# Autodesk Inventor assembly: 2020 Profile Pivot Joint
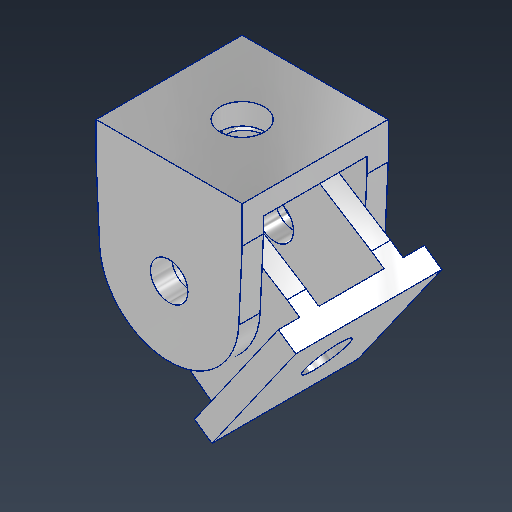
[picture p0: Inventor's stored thumbnail of the model, 512x512]
Saved by Autodesk Inventor 2026.2 (Build 302298010, 298A)
## iProperties
Created: 2026-05-13
Part Number: 2020 Profile Pivot Joint
Document SubType Name: Assembly
Designer: khw
Mass: 15.7543 g
Surface Area: 52.8246 cm^2
Volume: 5.83492 cm^3
Density: 2.7 g/cm^3
Author: khw
## iProperties of the stored document MemberDocs/xAaaaqacaAaaaaaaaAaaaqi21Wa
Created: 2026-05-13
Part Number: 2020 Profile Pivot Joint
Document SubType Name: Assembly
Designer: khw
Mass: 15.7543 g
Surface Area: 52.8246 cm^2
Volume: 5.83492 cm^3
Density: 2.7 g/cm^3
Author: khw
## Documents named in this file (4)
- C:\Users\khw\Desktop\ARD_v1\ARD_hardware\Common Objects\Profile\2020 Profile Pivot Joint\2020 Profile Pivot Joint.iam
- C:\Users\khw\Desktop\ARD_v1\ARD_hardware\Common Objects\Profile\2020 Profile Pivot Joint\Cylinder fixing parts_B parts.ipt
- C:\Users\khw\Desktop\ARD_v1\ARD_hardware\Common Objects\Profile\2020 Profile Pivot Joint\Cylinder fixing parts_A parts.ipt
- C:\Users\khw\Desktop\ARD_v1\ARD_hardware\Common Objects\Profile\2020 Profile Pivot Joint\2020 Profile Pivot Joint_하위.ipt
## Components (2 placed, 2 different names)
1. Cylinder fixing parts_B parts:1 — 메이트:1, 플러쉬:1, 각도:1
2. Cylinder fixing parts_A parts:1 — 메이트:1, 플러쉬:1, 각도:1
## Relationships (3: Mate 1, Flush 1, Angle 1)
- 메이트:1 [Mate]: Cylinder fixing parts_B parts:1 ↔ Cylinder fixing parts_A parts:1
- 플러쉬:1 [Flush]: Cylinder fixing parts_B parts:1 ↔ Cylinder fixing parts_A parts:1
- 각도:1 [Angle] (60 deg): Cylinder fixing parts_B parts:1 ↔ Cylinder fixing parts_A parts:1
